# Autodesk Inventor assembly: MM0861AN105_G14_001
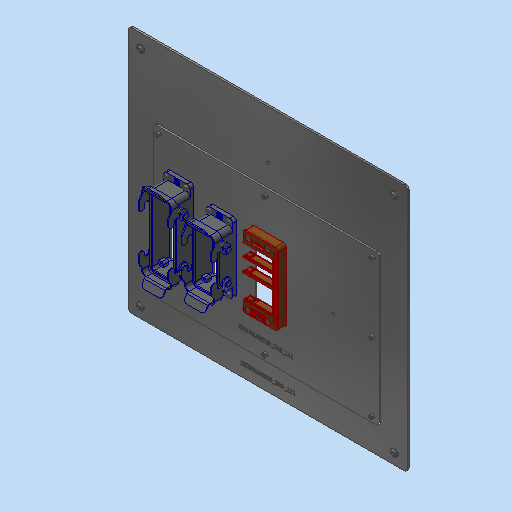
[picture p0: Inventor's stored thumbnail of the model, 512x512]
Saved by Autodesk Inventor 2023.3 (Build 273359000, 359)
## iProperties
Part Number: MM0861AN105_G14_001
Material: Generisch
Description: =<RBPARTNOTITLE2>
Document SubType Name: Assembly
Designer: ric7an
Mass: 4699.79 g
Surface Area: 4186.66 cm^2
Volume: 598.7 cm^3
Density: 7.85 g/cm^3
RBCHANGEDESCRIPTION1: Erstfreigabe
RBCHANGENO1: 00
RBDOCUMENTTYPE: DRF
RBDOCUMENTVERSION: 00
RBDRAWINGMAINSCALE: 1:1
RBDRAWINGMISSINGSPEC: --
RBDRAWINGVOLUME: --
RBDSV1: 0850
RBGBDETAILS: 43274
RBGBEDGESIN1: +0,5
RBGBEDGESIN2: +0,2
RBGBEDGESOUT1: -0,3
RBGBEDGESOUT2: -0,1
RBMATERIAL: =<Material>
RBMATMEETS: --
RBMATNO: =<Part Number>
RBORGUNITRESPONSIBLE1: AnP/TEF1
RBPARTMADEOF: --
RBPARTNO: SIEHE MNR
RBPARTNOTITLE1: modules with mounting plate L206
RBPARTNOTITLE2: Module mit Montageplatte L206
RBPARTSAFETYINDICATOR: --
RBSURFACE: --
RBSURFACE2: --
RBZEDGESNORM: ISO13715:2002-06
RBZGENDIMCLASS: m
RBZGENDIMNORM: ISO 2768-1:1989-11
RBZGENGEOCLASS: H
RBZGENGEONORM: ISO 2768-2:1989-11
RBZSURFACENORM: ISO13D2:2002-02
RBZTOLERANCENORM: ISO 14405-1:2010-12
AnP_Kommentar: --
MaxAbmaße: --
AnP_TemplVers: 20190222
AnP_Kategorie: 99
AnP_Material: =<Material>
Author: ric7an
Keywords: =<RBPARTMADEOF>
Comments: =<RBSURFACE2>
Revision Number: 01
## Documents named in this file (8)
- C:\Users\rea9an\Documents\Inventor\TCAI2412_te1910_EM\AS00000897.iam
- C:\Users\rea9an\Documents\Inventor\TCAI2412_te1910_EM\PT00004867.ipt
- C:\Users\rea9an\Documents\Inventor\TCAI2412_te1910_EM\PT00004392.ipt
- C:\Users\rea9an\Documents\Inventor\TCAI2412_te1910_EM\PT00004795.ipt
- C:\Users\rea9an\Documents\Inventor\TCAI2412_te1910_EM\AS00000980.iam
- C:\Users\rea9an\Documents\Inventor\TCAI2412_te1910_EM\AS00000981.iam
- C:\Users\rea9an\Documents\Inventor\TCAI2412_te1910_EM\AS00000979.iam
- C:\Users\rea9an\Documents\Inventor\TCAI2412_te1910_EM\PT00004796.ipt
## Components (17 placed, 7 different names)
1. PT00004795:1
2. PT00004796:1
3. AS00000980:1 [sub-assembly]
4. AS00000981:1 [sub-assembly]
5. AS00000979:1 [sub-assembly]
6. PT00004867:1
7. PT00004867:2
8. PT00004867:3
9. PT00004867:4
10. PT00004867:5
11. PT00004867:6
12. PT00004867:7
13. PT00004867:8
14. PT00004392:1
15. PT00004392:2
16. PT00004392:3
17. PT00004392:4
## Relationships (17: Insert 16, Angle 1)
- [Angle] (0 deg): PT00004796:1
- [Insert]: PT00004795:1 ↔ PT00004867:7
- [Insert]: PT00004795:1 ↔ PT00004867:6
- [Insert]: PT00004795:1 ↔ PT00004867:5
- [Insert]: PT00004795:1 ↔ PT00004867:4
- [Insert]: PT00004795:1 ↔ PT00004867:3
- [Insert]: PT00004795:1 ↔ PT00004867:2
- [Insert]: PT00004795:1 ↔ PT00004867:1
- [Insert]: PT00004795:1 ↔ PT00004867:8
- [Insert]: PT00004796:1 ↔ PT00004392:1
- [Insert]: PT00004796:1 ↔ PT00004392:2
- [Insert]: PT00004796:1 ↔ PT00004392:3
- [Insert]: PT00004796:1 ↔ PT00004392:4
- [Insert]: PT00004795:1 ↔ AS00000980:1
- [Insert]: PT00004795:1 ↔ AS00000981:1
- [Insert]: PT00004795:1 ↔ AS00000979:1
- [Insert]: PT00004795:1 ↔ PT00004796:1
